# Autodesk Inventor assembly: Ensamblaje1
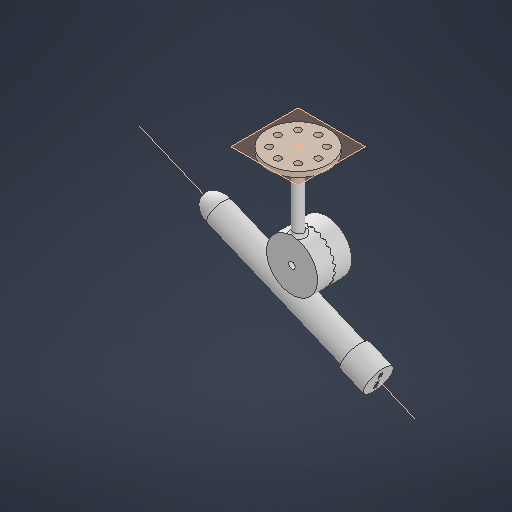
[picture p0: Inventor's stored thumbnail of the model, 512x512]
Saved by Autodesk Inventor 2027.1 (Build 311270010, 270A)
## iProperties
Created: 2026-09-14
Part Number: Ensamblaje1
Document SubType Name: Assembly
Designer: felip
Author: felip
## Documents named in this file (4)
- C:\Users\felip\Desktop\Ensamblaje1.iam
- C:\Users\felip\Desktop\ParteA.ipt
- C:\Users\felip\Desktop\ParteBalv.ipt
- C:\Users\felip\Desktop\Tapa.ipt
## Components (3 placed, 3 different names)
1. ParteA:1 — Coincidencia:2, Coincidencia:5
2. ParteBalv:1 — Coincidencia:2, Coincidencia:3, Coincidencia:4
3. Tapa:1 — Coincidencia:3, Coincidencia:4
## Relationships (4: Mate 4)
- Coincidencia:2 [Mate]: ParteA:1 ↔ ParteBalv:1
- Coincidencia:3 [Mate] (5 mm): ParteBalv:1 ↔ Tapa:1
- Coincidencia:4 [Mate]: ParteBalv:1 ↔ Tapa:1
- Coincidencia:5 [Mate]: ParteA:1
